# Autodesk Inventor assembly: Assembly1
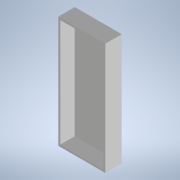
[picture p0: Inventor's stored thumbnail of the model, 180x180]
Saved by Autodesk Inventor 2022.6 (Build 266554000, 554)
## iProperties
Created: 2025-05-19
Part Number: Assembly1
Document SubType Name: Assembly
Designer: Dragos Macovei
Author: Dragos Macovei
## Documents named in this file (4)
- C:\Users\Dragos Macovei\Documents\Inventor_3d_parts\PAT\Pat_Colt_tara_190_125_26\Box_underbad\Assembly1.iam
- C:\Users\Dragos Macovei\Documents\Inventor_3d_parts\PAT\Pat_Colt_tara_190_125_26\Box_underbad\fund_box.ipt
- C:\Users\Dragos Macovei\Documents\Inventor_3d_parts\PAT\Pat_Colt_tara_190_125_26\Box_underbad\perete-box_lateral.ipt
- C:\Users\Dragos Macovei\Documents\Inventor_3d_parts\PAT\Pat_Colt_tara_190_125_26\Box_underbad\front_box.ipt
## Components (5 placed, 3 different names)
1. fund_box:1 — Mate:1, Mate:2, Flush:1, Flush:2, Flush:3, Flush:4
2. perete-box_lateral:1 — Mate:2, Flush:1, Flush:4, Mate:4
3. perete-box_lateral:2 — Mate:1, Flush:2, Flush:3, Mate:3, Flush:5, Flush:6, Flush:7, Flush:8
4. front_box:1 — Mate:4, Flush:7, Flush:8
5. front_box:2 — Mate:3, Flush:5, Flush:6
## Relationships (12: Flush 8, Mate 4)
- Mate:1: fund_box:1 ↔ perete-box_lateral:2
- Mate:2: fund_box:1 ↔ perete-box_lateral:1
- Flush:1: fund_box:1 ↔ perete-box_lateral:1
- Flush:2: fund_box:1 ↔ perete-box_lateral:2
- Flush:3: fund_box:1 ↔ perete-box_lateral:2
- Flush:4: fund_box:1 ↔ perete-box_lateral:1
- Mate:3: perete-box_lateral:2 ↔ front_box:2
- Flush:5: perete-box_lateral:2 ↔ front_box:2
- Flush:6: perete-box_lateral:2 ↔ front_box:2
- Mate:4: perete-box_lateral:1 ↔ front_box:1
- Flush:7: perete-box_lateral:2 ↔ front_box:1
- Flush:8: perete-box_lateral:2 ↔ front_box:1
